# Autodesk Inventor assembly: MODIFICANDO ESAMBLE terminado
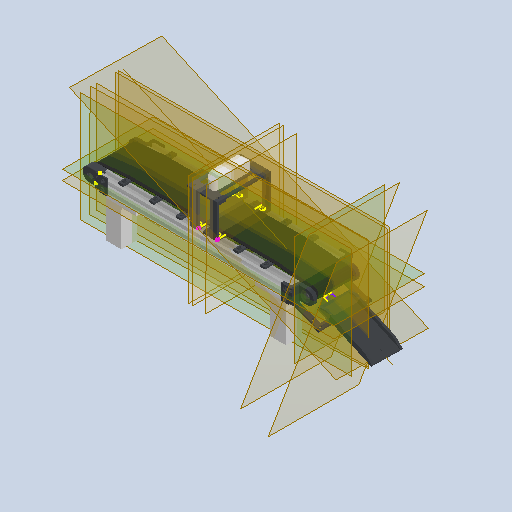
[picture p0: Inventor's stored thumbnail of the model, 512x512]
Saved by Autodesk Inventor 2025.3 (Build 293356000, 356)
## iProperties
Created: 2026-09-21
Part Number: MODIFICANDO ESAMBLE terminado
Document SubType Name: Assembly
Designer: ASUS
Mass: 2449.09 g
Surface Area: 8022.63 cm^2
Volume: 1719.36 cm^3
Density: 1.42442 g/cm^3
Author: ASUS
## Documents named in this file (29)
- C:\Users\STEVEN LONDOÑO\Documents\BANDA TRANSPORTADORA TERMINADA\BANDA TRANSPORTADORA VALIDACION MECANICA V2\BANDA_TRANSPORTADORA_PLA_SBR_FINAL.iam
- C:\Users\STEVEN LONDOÑO\Documents\BANDA TRANSPORTADORA TERMINADA\BANDA TRANSPORTADORA VALIDACION MECANICA V2\Riel Banda.ipt
- C:\Users\STEVEN LONDOÑO\Documents\BANDA TRANSPORTADORA TERMINADA\BANDA TRANSPORTADORA VALIDACION MECANICA V2\Pata1.ipt
- C:\Users\STEVEN LONDOÑO\Documents\BANDA TRANSPORTADORA TERMINADA\BANDA TRANSPORTADORA VALIDACION MECANICA V2\Pata2.ipt
- C:\Users\STEVEN LONDOÑO\Documents\BANDA TRANSPORTADORA TERMINADA\BANDA TRANSPORTADORA VALIDACION MECANICA V2\palito arriba de la banda.ipt
- C:\Users\STEVEN LONDOÑO\Documents\BANDA TRANSPORTADORA TERMINADA\BANDA TRANSPORTADORA VALIDACION MECANICA V2\Pieza negra.ipt
- C:\Users\STEVEN LONDOÑO\Documents\BANDA TRANSPORTADORA TERMINADA\BANDA TRANSPORTADORA VALIDACION MECANICA V2\pieza negra derecha.ipt
- C:\Users\STEVEN LONDOÑO\Documents\BANDA TRANSPORTADORA TERMINADA\BANDA TRANSPORTADORA VALIDACION MECANICA V2\BaseRodamiento.ipt
- C:\Users\STEVEN LONDOÑO\Documents\BANDA TRANSPORTADORA TERMINADA\BANDA TRANSPORTADORA VALIDACION MECANICA V2\Base Rodamiento delgado.ipt
- C:\Users\STEVEN LONDOÑO\Documents\BANDA TRANSPORTADORA TERMINADA\BANDA TRANSPORTADORA VALIDACION MECANICA V2\Rodamiento grande.ipt
- C:\Users\STEVEN LONDOÑO\Documents\BANDA TRANSPORTADORA TERMINADA\BANDA TRANSPORTADORA VALIDACION MECANICA V2\rodillo con rodamiento.ipt
- C:\Users\STEVEN LONDOÑO\Documents\BANDA TRANSPORTADORA TERMINADA\BANDA TRANSPORTADORA VALIDACION MECANICA V2\rodamiento.ipt
- C:\Users\STEVEN LONDOÑO\Documents\BANDA TRANSPORTADORA TERMINADA\BANDA TRANSPORTADORA VALIDACION MECANICA V2\rodillo con rodamiento 2.ipt
- C:\Users\STEVEN LONDOÑO\Documents\BANDA TRANSPORTADORA TERMINADA\BANDA TRANSPORTADORA VALIDACION MECANICA V2\Banda.ipt
- C:\Users\STEVEN LONDOÑO\Documents\BANDA TRANSPORTADORA TERMINADA\BANDA TRANSPORTADORA VALIDACION MECANICA V2\SERVOMOTOR.ipt
- C:\Users\STEVEN LONDOÑO\Documents\BANDA TRANSPORTADORA TERMINADA\BANDA TRANSPORTADORA VALIDACION MECANICA V2\Rodillos mitad banda.ipt
- C:\Users\STEVEN LONDOÑO\Documents\BANDA TRANSPORTADORA TERMINADA\BANDA TRANSPORTADORA VALIDACION MECANICA V2\Pieza8.ipt
- C:\Users\STEVEN LONDOÑO\Documents\BANDA TRANSPORTADORA TERMINADA\BANDA TRANSPORTADORA VALIDACION MECANICA V2\Desviador.ipt
- C:\Users\STEVEN LONDOÑO\Documents\BANDA TRANSPORTADORA TERMINADA\BANDA TRANSPORTADORA VALIDACION MECANICA V2\Cabezal camara.ipt
- C:\Users\STEVEN LONDOÑO\Documents\BANDA TRANSPORTADORA TERMINADA\BANDA TRANSPORTADORA VALIDACION MECANICA V2\Paralela_diseno.ipt
- C:\Users\STEVEN LONDOÑO\Documents\BANDA TRANSPORTADORA TERMINADA\BANDA TRANSPORTADORA VALIDACION MECANICA V2\Laiminamodific.ipt
- C:\Users\STEVEN LONDOÑO\Documents\BANDA TRANSPORTADORA TERMINADA\BANDA TRANSPORTADORA VALIDACION MECANICA V2\Camara.ipt
- C:\Users\STEVEN LONDOÑO\Documents\BANDA TRANSPORTADORA TERMINADA\BANDA TRANSPORTADORA VALIDACION MECANICA V2\Prisionero_M3x4.ipt
- C:\Users\STEVEN LONDOÑO\Documents\BANDA TRANSPORTADORA TERMINADA\BANDA TRANSPORTADORA VALIDACION MECANICA V2\BANDA_TRANSPORTADORA_PLA_SBR_FINAL\AIP\FEA\fmgkp2n34.fins
- C:\Users\STEVEN LONDOÑO\Documents\BANDA TRANSPORTADORA TERMINADA\BANDA TRANSPORTADORA VALIDACION MECANICA V2\BANDA_TRANSPORTADORA_PLA_SBR_FINAL\AIP\FEA\fmgkp2n34.fsat
- C:\Users\STEVEN LONDOÑO\Documents\BANDA TRANSPORTADORA TERMINADA\BANDA TRANSPORTADORA VALIDACION MECANICA V2\BANDA_TRANSPORTADORA_PLA_SBR_FINAL\AIP\FEA\fmgkp2n34.ftes
- C:\Users\STEVEN LONDOÑO\Documents\BANDA TRANSPORTADORA TERMINADA\BANDA TRANSPORTADORA VALIDACION MECANICA V2\BANDA_TRANSPORTADORA_PLA_SBR_FINAL\AIP\FEA\fmgkp2n34.fwiz
- C:\Users\STEVEN LONDOÑO\Documents\BANDA TRANSPORTADORA TERMINADA\BANDA TRANSPORTADORA VALIDACION MECANICA V2\BANDA_TRANSPORTADORA_PLA_SBR_FINAL\AIP\FEA\fmgkp2nr4.fmsh
- C:\Users\STEVEN LONDOÑO\Documents\BANDA TRANSPORTADORA TERMINADA\BANDA TRANSPORTADORA VALIDACION MECANICA V2\BANDA_TRANSPORTADORA_PLA_SBR_FINAL\AIP\FEA\fmgkp2ns0.fres
## Components (42 placed, 22 different names)
1. Riel Banda:1 — Nivelación:5, Nivelación:6, Coincidencia:3, Coincidencia:5, Nivelación:9, Nivelación:10, Coincidencia:6, Nivelación:13, Nivelación:14, Nivelación:16, Nivelación:17, Coincidencia:8, Nivelación:20, Nivelación:21, Coincidencia:12, Nivelación:23, Coincidencia:13, Coincidencia:14, Nivelación:24, Coincidencia:15, Coincidencia:19, Coincidencia:20, Coincidencia:29, Nivelación:32, Coincidencia:62, Nivelación:43
2. Riel Banda:2 — Coincidencia:2, Nivelación:3, Nivelación:4, Coincidencia:4, Nivelación:7, Nivelación:8, Nivelación:12, Nivelación:13, Nivelación:15, Coincidencia:7, Nivelación:18, Nivelación:19, Coincidencia:9, Coincidencia:10, Nivelación:22, Coincidencia:11, Coincidencia:22, Coincidencia:25, Nivelación:29, Coincidencia:26, Nivelación:30, Nivelación:31, Coincidencia:27, De rotación:8, De rotación:9, De rotación:10, Coincidencia:52, Nivelación:33, Nivelación:34, Coincidencia:53, Nivelación:35, Nivelación:36, Coincidencia:54, Nivelación:37, Nivelación:38, Coincidencia:55, Nivelación:39, Coincidencia:63, Nivelación:44
3. Pata1:1 — Coincidencia:5, Nivelación:9, Nivelación:10
4. Pata1:2 — Coincidencia:2, Nivelación:3, Nivelación:4, Nivelación:11
5. Pata2:1 — Coincidencia:4, Nivelación:7, Nivelación:8
6. Pata2:2 — Nivelación:5, Nivelación:6, Coincidencia:3, Nivelación:11
7. palito arriba de la banda:1 — Coincidencia:6, Nivelación:12, Nivelación:14, Nivelación:15
8. palito arriba de la banda:2 — Coincidencia:8, Nivelación:18, Nivelación:19
9. palito arriba de la banda:3 — Coincidencia:7, Nivelación:16, Nivelación:17
10. palito arriba de la banda:4 — Coincidencia:9, Nivelación:20, Nivelación:21
11. Pieza negra:1 — Coincidencia:10, Nivelación:22, Coincidencia:11, Coincidencia:21, Nivelación:27
12. Pieza negra:2 — Coincidencia:12, Nivelación:23, Coincidencia:13, Coincidencia:30
13. pieza negra derecha:2 — Coincidencia:14, Nivelación:24, Coincidencia:15, Coincidencia:18, Nivelación:26
14. BaseRodamiento:1 — Coincidencia:18, Coincidencia:19, Nivelación:26, Coincidencia:20
15. BaseRodamiento:5 — Coincidencia:21, Nivelación:27, Coincidencia:22, De rotación:15
16. Base Rodamiento delgado:1 — Coincidencia:25, Nivelación:29, Nivelación:30, Coincidencia:28
17. Rodamiento grande:1 — Coincidencia:26, Nivelación:31, Coincidencia:27, Coincidencia:28, De rotación:13
18. BaseRodamiento:6 — Coincidencia:29, Nivelación:32, Coincidencia:30, De rotación:14, Asiento_aro_6_1, Asiento_aro_6_2, Asiento_aro_6_3
19. rodamiento:3 — Coincidencia:50, De rotación:15, Giro_rodillo_conducido, Giro_conducido_verificado
20. Banda:1 — Montaje_Banda_1_1, Montaje_Banda_1_2, Montaje_Banda_1_3
21. SERVOMOTOR:2 — Coincidencia:66, De rotación:16, Montaje_SERVOMOTOR_2_1, Montaje_SERVOMOTOR_2_2
22. Rodillos mitad banda:1 — De rotación:8
23. Rodillos mitad banda:2 — De rotación:9
24. Rodillos mitad banda:3 — De rotación:10
25. rodillo con rodamiento 2:1 — Coincidencia:50, Coincidencia:51, Giro_rodillo_conducido, Giro_conducido_verificado
26. rodillo con rodamiento:2 — Coincidencia:47, Coincidencia:48, Coincidencia:49, Segundo apoyo sobre eje del rodillo motriz, Prisionero_sobre_motriz_1, Prisionero_sobre_motriz_2, Prisionero_sobre_motriz_3
27. rodamiento:5 — Coincidencia:47, De rotación:13
28. rodamiento:6 — Coincidencia:48, De rotación:14, Coincidencia:49, Asiento_aro_6_1, Asiento_aro_6_2, Asiento_aro_6_3
29. rodamiento:7 — Coincidencia:51, Alojamiento_rodamiento_7_1, Alojamiento_rodamiento_7_2, Alojamiento_rodamiento_7_3
30. Pieza8:1 — Coincidencia:60, Nivelación:42, Coincidencia:61, Nivelación de montaje 61
31. Desviador:1 — De rotación:16
32. Cabezal camara:1 — Coincidencia:56, Nivelación:40, Coincidencia:57, Coincidencia:58, Nivelación:41, Coincidencia:59, Coincidencia:60, Nivelación:42, Coincidencia:61, Coincidencia:67, Coincidencia:68, Nivelación de montaje 57, Nivelación de montaje 59, Nivelación de montaje 61
33. Paralela_diseno:1 — Coincidencia:62, Nivelación:43, Nivelación:45, Montaje_Paralela_diseno_1_1
34. palito arriba de la banda:5 — Coincidencia:52, Nivelación:33, Nivelación:34
35. palito arriba de la banda:6 — Coincidencia:53, Nivelación:35, Nivelación:36
36. Pieza8:5 — Coincidencia:54, Nivelación:37, Nivelación:38
37. Pieza8:6 — Coincidencia:55, Nivelación:39, Coincidencia:56, Nivelación:40, Coincidencia:57, Nivelación de montaje 57, Montaje_Pieza8_6_1
38. Pieza8:7 — Coincidencia:58, Nivelación:41, Coincidencia:59, Nivelación de montaje 59
39. Paralela_diseno:3 — Coincidencia:63, Nivelación:44, Nivelación:45, Coincidencia:65
40. Laiminamodific:1 — Coincidencia:65, Coincidencia:66, Montaje_Laiminamodific_1_1, Montaje_Laiminamodific_1_2
41. Camara:1 — Coincidencia:67, Coincidencia:68, Montaje_Camara_1_1, Montaje_Camara_1_2
42. Prisionero_M3x4:1 — Prisionero_sobre_motriz_1, Prisionero_sobre_motriz_2, Prisionero_sobre_motriz_3
## Relationships (120: Flush 64, Mate 47, RevoluteJoint 9)
- Coincidencia:2 [Mate]: Riel Banda:2 ↔ Pata1:2
- Nivelación:3 [Flush]: Riel Banda:2 ↔ Pata1:2
- Nivelación:4 [Flush] (-15 mm): Riel Banda:2 ↔ Pata1:2
- Nivelación:5 [Flush] (15 mm): Riel Banda:1 ↔ Pata2:2
- Nivelación:6 [Flush]: Riel Banda:1 ↔ Pata2:2
- Coincidencia:3 [Mate]: Riel Banda:1 ↔ Pata2:2
- Coincidencia:4 [Mate]: Riel Banda:2 ↔ Pata2:1
- Nivelación:7 [Flush]: Riel Banda:2 ↔ Pata2:1
- Nivelación:8 [Flush] (-15 mm): Riel Banda:2 ↔ Pata2:1
- Coincidencia:5 [Mate]: Riel Banda:1 ↔ Pata1:1
- Nivelación:9 [Flush]: Riel Banda:1 ↔ Pata1:1
- Nivelación:10 [Flush] (-15 mm): Riel Banda:1 ↔ Pata1:1
- Nivelación:11 [Flush]: Pata1:2 ↔ Pata2:2
- Coincidencia:6 [Mate]: Riel Banda:1 ↔ palito arriba de la banda:1
- Nivelación:12 [Flush]: Riel Banda:2 ↔ palito arriba de la banda:1
- Nivelación:13 [Flush]: Riel Banda:1 ↔ Riel Banda:2
- Nivelación:14 [Flush]: Riel Banda:1 ↔ palito arriba de la banda:1
- Nivelación:15 [Flush] (220 mm): Riel Banda:2 ↔ palito arriba de la banda:1
- Coincidencia:7 [Mate]: Riel Banda:2 ↔ palito arriba de la banda:3
- Nivelación:16 [Flush]: Riel Banda:1 ↔ palito arriba de la banda:3
- Nivelación:17 [Flush] (290 mm): Riel Banda:1 ↔ palito arriba de la banda:3
- Coincidencia:8 [Mate]: Riel Banda:1 ↔ palito arriba de la banda:2
- Nivelación:18 [Flush]: Riel Banda:2 ↔ palito arriba de la banda:2
- Nivelación:19 [Flush] (360 mm): Riel Banda:2 ↔ palito arriba de la banda:2
- Coincidencia:9 [Mate]: Riel Banda:2 ↔ palito arriba de la banda:4
- Nivelación:20 [Flush]: Riel Banda:1 ↔ palito arriba de la banda:4
- Nivelación:21 [Flush] (440 mm): Riel Banda:1 ↔ palito arriba de la banda:4
- Coincidencia:10 [Mate]: Riel Banda:2 ↔ Pieza negra:1
- Nivelación:22 [Flush]: Riel Banda:2 ↔ Pieza negra:1
- Coincidencia:11 [Mate]: Riel Banda:2 ↔ Pieza negra:1
- Coincidencia:12 [Mate]: Riel Banda:1 ↔ Pieza negra:2
- Nivelación:23 [Flush]: Riel Banda:1 ↔ Pieza negra:2
- Coincidencia:13 [Mate]: Riel Banda:1 ↔ Pieza negra:2
- Coincidencia:14 [Mate]: Riel Banda:1 ↔ pieza negra derecha:2
- Nivelación:24 [Flush]: Riel Banda:1 ↔ pieza negra derecha:2
- Coincidencia:15 [Mate]: Riel Banda:1 ↔ pieza negra derecha:2
- Coincidencia:18 [Mate]: pieza negra derecha:2 ↔ BaseRodamiento:1
- Coincidencia:19 [Mate]: Riel Banda:1 ↔ BaseRodamiento:1
- Nivelación:26 [Flush]: pieza negra derecha:2 ↔ BaseRodamiento:1
- Coincidencia:20 [Mate]: Riel Banda:1 ↔ BaseRodamiento:1
- Coincidencia:21 [Mate]: Pieza negra:1 ↔ BaseRodamiento:5
- Nivelación:27 [Flush]: Pieza negra:1 ↔ BaseRodamiento:5
- Coincidencia:22 [Mate]: Riel Banda:2 ↔ BaseRodamiento:5
- Coincidencia:25 [Mate]: Riel Banda:2 ↔ Base Rodamiento delgado:1
- Nivelación:29 [Flush]: Riel Banda:2 ↔ Base Rodamiento delgado:1
- Coincidencia:26 [Mate]: Riel Banda:2 ↔ Rodamiento grande:1
- Nivelación:30 [Flush]: Riel Banda:2 ↔ Base Rodamiento delgado:1
- Nivelación:31 [Flush]: Riel Banda:2 ↔ Rodamiento grande:1
- Coincidencia:27 [Mate]: Riel Banda:2 ↔ Rodamiento grande:1
- Coincidencia:28 [Mate]: Base Rodamiento delgado:1 ↔ Rodamiento grande:1
- Coincidencia:29 [Mate]: Riel Banda:1 ↔ BaseRodamiento:6
- Nivelación:32 [Flush] (-0.6924 mm): Riel Banda:1 ↔ BaseRodamiento:6
- Coincidencia:30 [Mate]: Pieza negra:2 ↔ BaseRodamiento:6
- De rotación:8 [RevoluteJoint]: Riel Banda:2 ↔ Rodillos mitad banda:1
- De rotación:9 [RevoluteJoint]: Riel Banda:2 ↔ Rodillos mitad banda:2
- De rotación:10 [RevoluteJoint]: Riel Banda:2 ↔ Rodillos mitad banda:3
- Coincidencia:47 [Mate]: rodillo con rodamiento:2 ↔ rodamiento:5
- Coincidencia:48 [Mate]: rodillo con rodamiento:2 ↔ rodamiento:6
- De rotación:13 [RevoluteJoint]: Rodamiento grande:1 ↔ rodamiento:5
- De rotación:14 [RevoluteJoint]: BaseRodamiento:6 ↔ rodamiento:6
- Coincidencia:49 [Mate]: rodillo con rodamiento:2 ↔ rodamiento:6
- Coincidencia:50 [Mate]: rodamiento:3 ↔ rodillo con rodamiento 2:1
- Coincidencia:51 [Mate]: rodillo con rodamiento 2:1 ↔ rodamiento:7
- De rotación:15 [RevoluteJoint]: BaseRodamiento:5 ↔ rodamiento:3
- Coincidencia:52 [Mate]: Riel Banda:2 ↔ palito arriba de la banda:5
- Nivelación:33 [Flush]: Riel Banda:2 ↔ palito arriba de la banda:5
- Nivelación:34 [Flush] (140 mm): Riel Banda:2 ↔ palito arriba de la banda:5
- Coincidencia:53 [Mate]: Riel Banda:2 ↔ palito arriba de la banda:6
- Nivelación:35 [Flush]: Riel Banda:2 ↔ palito arriba de la banda:6
- Nivelación:36 [Flush] (70 mm): Riel Banda:2 ↔ palito arriba de la banda:6
- Coincidencia:54 [Mate]: Riel Banda:2 ↔ Pieza8:5
- Nivelación:37 [Flush]: Riel Banda:2 ↔ Pieza8:5
- Nivelación:38 [Flush] (245 mm): Riel Banda:2 ↔ Pieza8:5
- Coincidencia:55 [Mate]: Riel Banda:2 ↔ Pieza8:6
- Nivelación:39 [Flush]: Riel Banda:2 ↔ Pieza8:6
- Coincidencia:56 [Mate]: Cabezal camara:1 ↔ Pieza8:6
- Nivelación:40 [Flush]: Cabezal camara:1 ↔ Pieza8:6
- Coincidencia:57 [Mate]: Cabezal camara:1 ↔ Pieza8:6
- Coincidencia:58 [Mate]: Cabezal camara:1 ↔ Pieza8:7
- Nivelación:41 [Flush]: Cabezal camara:1 ↔ Pieza8:7
- Coincidencia:59 [Mate]: Cabezal camara:1 ↔ Pieza8:7
- Coincidencia:60 [Mate]: Pieza8:1 ↔ Cabezal camara:1
- Nivelación:42 [Flush]: Pieza8:1 ↔ Cabezal camara:1
- Coincidencia:61 [Mate]: Pieza8:1 ↔ Cabezal camara:1
- Coincidencia:62 [Mate]: Riel Banda:1 ↔ Paralela_diseno:1
- Nivelación:43 [Flush] (3.5 mm): Riel Banda:1 ↔ Paralela_diseno:1
- Coincidencia:63 [Mate]: Riel Banda:2 ↔ Paralela_diseno:3
- Nivelación:44 [Flush] (3.5 mm): Riel Banda:2 ↔ Paralela_diseno:3
- Nivelación:45 [Flush]: Paralela_diseno:1 ↔ Paralela_diseno:3
- Coincidencia:65 [Mate]: Paralela_diseno:3 ↔ Laiminamodific:1
- Coincidencia:66 [Mate]: SERVOMOTOR:2 ↔ Laiminamodific:1
- De rotación:16 [RevoluteJoint]: SERVOMOTOR:2 ↔ Desviador:1
- Coincidencia:67 [Mate]: Cabezal camara:1 ↔ Camara:1
- Coincidencia:68 [Mate]: Cabezal camara:1 ↔ Camara:1
- Nivelación de montaje 57 [Flush]: Cabezal camara:1 ↔ Pieza8:6
- Nivelación de montaje 59 [Flush]: Cabezal camara:1 ↔ Pieza8:7
- Nivelación de montaje 61 [Flush]: Pieza8:1 ↔ Cabezal camara:1
- Montaje_Pieza8_6_1 [Flush]: Pieza8:6
- Montaje_Camara_1_1 [Flush]: Camara:1
- Montaje_Camara_1_2 [Flush] (-0.9462 mm): Camara:1
- Montaje_Paralela_diseno_1_1 [Flush]: Paralela_diseno:1
- Montaje_Laiminamodific_1_1 [Flush]: Laiminamodific:1
- Montaje_Laiminamodific_1_2 [Flush]: Laiminamodific:1
- Montaje_SERVOMOTOR_2_1 [Flush]: SERVOMOTOR:2
- Montaje_SERVOMOTOR_2_2 [Flush]: SERVOMOTOR:2
- Montaje_Banda_1_1 [Flush]: Banda:1
- Montaje_Banda_1_2 [Flush]: Banda:1
- Montaje_Banda_1_3 [Flush]: Banda:1
- Alojamiento_rodamiento_7_1 [Flush]: rodamiento:7
- Alojamiento_rodamiento_7_2 [Flush]: rodamiento:7
- Alojamiento_rodamiento_7_3 [Flush]: rodamiento:7
- Giro_rodillo_conducido [RevoluteJoint]: rodamiento:3 ↔ rodillo con rodamiento 2:1
- Giro_conducido_verificado [RevoluteJoint]: rodamiento:3 ↔ rodillo con rodamiento 2:1
- Segundo apoyo sobre eje del rodillo motriz [Mate]: rodillo con rodamiento:2
- Asiento_aro_6_1 [Flush] (2.305 mm): BaseRodamiento:6 ↔ rodamiento:6
- Asiento_aro_6_2 [Flush] (1.8089 mm): BaseRodamiento:6 ↔ rodamiento:6
- Asiento_aro_6_3 [Flush] (2.896 mm): BaseRodamiento:6 ↔ rodamiento:6
- Prisionero_sobre_motriz_1 [Flush]: rodillo con rodamiento:2 ↔ Prisionero_M3x4:1
- Prisionero_sobre_motriz_2 [Flush]: rodillo con rodamiento:2 ↔ Prisionero_M3x4:1
- Prisionero_sobre_motriz_3 [Flush]: rodillo con rodamiento:2 ↔ Prisionero_M3x4:1
## Named parameters: sa_0 = 0, sa_1 = -28, sa_2 = 1.73134e-07, sa_3 = 0, sa_4 = -28, sa_5 = 1.73134e-07, sa_6 = 0, sa_7 = -28, sa_8 = 1.73134e-07, sa_9 = 0, sa_10 = -28, sa_11 = 0, sa_12 = 0, sa_13 = -28, sa_14 = 0, sa_15 = 0, sa_16 = -28, sa_17 = 0, sa_18 = 0, sa_19 = -28, sa_20 = 0
note: some values were not read from the file. Shown as the stored number, unit unknown: "sa_0", "sa_1", "sa_2", "sa_3", "sa_4", "sa_5", "sa_6", "sa_7", "sa_8", "sa_9", "sa_10", "sa_11", "sa_12", "sa_13", "sa_14", "sa_15", "sa_16", "sa_17", "sa_18", "sa_19", "sa_20".
